# Autodesk Inventor assembly: US_ASM
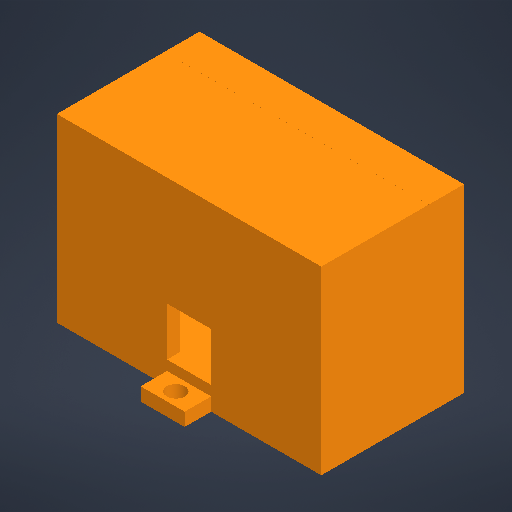
[picture p0: Inventor's stored thumbnail of the model, 512x512]
Saved by Autodesk Inventor 2026.2 (Build 302298010, 298A)
## iProperties
Created: 2026-10-11
Part Number: US_ASM
Document SubType Name: Assembly
Designer: User
Author: User
## Documents named in this file (4)
- D:\Autodesk Invento Pro Work\Honours Project\Parts\US_ASM.iam
- D:\Autodesk Invento Pro Work\Honours Project\Parts\US_sensor_mount_front.ipt
- D:\Autodesk Invento Pro Work\Honours Project\Parts\HC-SR04.iam
- D:\Autodesk Invento Pro Work\Honours Project\Parts\US_sensor_mount_back.ipt
## Components (3 placed, 3 different names)
1. US_sensor_mount_front:1 — Mate:1, Mate:2
2. HC-SR04:1 [sub-assembly] — Mate:1
3. US_sensor_mount_back:1 — Mate:2
## Relationships (2: Mate 2)
- Mate:1: US_sensor_mount_front:1 ↔ HC-SR04:1
- Mate:2: US_sensor_mount_front:1 ↔ US_sensor_mount_back:1
